# Autodesk Inventor assembly: MM0948AN140_G00_840
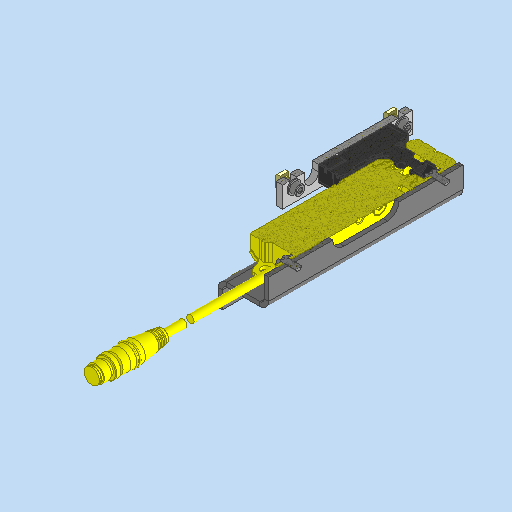
[picture p0: Inventor's stored thumbnail of the model, 512x512]
Saved by Autodesk Inventor 2023.3 (Build 273359000, 359)
## iProperties
Created: 2023-03-23
Part Number: MM0948AN140_G00_840
Project: 0850
Description: =<RBPARTNOTITLE2>
Document SubType Name: Assembly
Designer: FH/Wi
Mass: 432.694 g
Surface Area: 602.46 cm^2
Volume: 140.943 cm^3
Density: 3.07 g/cm^3
AnP_Material: =<Material>
RBMATERIAL: =<Material>
RBMATNO: =<Part Number>
RBPARTMADEOF: --
RBDRAWINGMISSINGSPEC: --
AnP_Kategorie: 98
RBPARTNOTITLE2: hier Bezeichnung eintragen
RBGBREMARKSINDEX: Angabe offen!
RBSURFACE: --
RBPARTNOTITLE1: enter description here
RBPARTNO: SIEHE MNR
Author: FH/Wi
Keywords: =<RBPARTMADEOF>
Comments: =<RBSURFACE2>
Revision Number: 01
## Documents named in this file (10)
- C:\Users\rea9an\Documents\Inventor\TCAI2412_te1910_EM\AS00000955.iam
- C:\Users\rea9an\Documents\Inventor\TCAI2412_te1910_EM\PT00004396.ipt
- C:\Users\rea9an\Documents\Inventor\TCAI2412_te1910_EM\PT00004399.ipt
- C:\Users\rea9an\Documents\Inventor\TCAI2412_te1910_EM\PT00004877.ipt
- C:\Users\rea9an\Documents\Inventor\TCAI2412_te1910_EM\PT00004664.ipt
- C:\Users\rea9an\Documents\Inventor\TCAI2412_te1910_EM\PT00004294.ipt
- C:\Users\rea9an\Documents\Inventor\TCAI2412_te1910_EM\PT00004778.ipt
- C:\Users\rea9an\Documents\Inventor\TCAI2412_te1910_EM\PT00004866.ipt
- C:\Users\rea9an\Documents\Inventor\TCAI2412_te1910_EM\PT00004666.ipt
- C:\Users\rea9an\Documents\Inventor\TCAI2412_te1910_EM\PT00004389.ipt
## Components (20 placed, 9 different names)
1. PT00004664:1 — Winkel:5, Fluchtend:7, Winkel:6, Einfügen:13, Einfügen:14
2. PT00004666:1 — Passend:8, Passend:13, Passend:14, Passend:25, Winkel:4, Fluchtend:3, Einfügen:7, Einfügen:8, Winkel:5, Fluchtend:7, Passend:30, Passend:31
3. PT00004389:1 — Einfügen:5
4. PT00004389:2 — Einfügen:6
5. PT00004877:1 — Einfügen:7
6. PT00004877:2 — Einfügen:8
7. PT00004866:1
8. PT00004866:2
9. PT00004866:3 — Fluchtend:3
10. PT00004866:4 — Passend:25
11. PT00004778:1
12. PT00004778:2
13. PT00004778:3 — Passend:13
14. PT00004778:4 — Passend:14
15. PT00004396:1 — Passend:6, Einfügen:5, Einfügen:6, Einfügen:13, Einfügen:14
16. PT00004399:1 — Passend:6, Passend:8, Passend:30, Passend:31
17. PT00004294:1 — Winkel:4, Fluchtend:5, Fluchtend:6
18. PT00004294:2 — Fluchtend:6
19. PT00004294:3 — Winkel:6
20. PT00004294:4 — Fluchtend:5
## Relationships (35: Insert 14, Mate 12, Flush 6, Angle 3)
- Passend:6 [Mate]: PT00004396:1 ↔ PT00004399:1
- Passend:8 [Mate]: PT00004666:1 ↔ PT00004399:1
- [Insert]: PT00004866:1 ↔ PT00004778:1
- [Insert]: PT00004866:2 ↔ PT00004778:2
- [Insert]: PT00004866:4 ↔ PT00004778:3
- [Insert]: PT00004866:3 ↔ PT00004778:4
- Passend:13 [Mate]: PT00004666:1 ↔ PT00004778:3
- Passend:14 [Mate]: PT00004666:1 ↔ PT00004778:4
- [Mate]: PT00004866:1 ↔ PT00004866:2
- Passend:25 [Mate] (-7.5 mm): PT00004666:1 ↔ PT00004866:4
- Winkel:4 [Angle] (0 deg): PT00004666:1 ↔ PT00004294:1
- Fluchtend:3 [Flush] (7.5 mm): PT00004666:1 ↔ PT00004866:3
- [Flush]: PT00004866:3 ↔ PT00004866:4
- Einfügen:5 [Insert]: PT00004389:1 ↔ PT00004396:1
- Einfügen:6 [Insert]: PT00004389:2 ↔ PT00004396:1
- Einfügen:7 [Insert] (8.4 mm): PT00004666:1 ↔ PT00004877:1
- Einfügen:8 [Insert] (8.4 mm): PT00004666:1 ↔ PT00004877:2
- Fluchtend:5 [Flush] (25 mm): PT00004294:1 ↔ PT00004294:4
- [Insert] (3.7 mm): PT00004778:1 ↔ PT00004294:4
- [Insert] (5.2 mm): PT00004778:3 ↔ PT00004294:1
- [Insert] (5.2 mm): PT00004778:4 ↔ PT00004294:2
- [Insert] (3.7 mm): PT00004778:2 ↔ PT00004294:3
- Fluchtend:6 [Flush]: PT00004294:1 ↔ PT00004294:2
- [Mate]: PT00004664:1 ↔ PT00004778:2
- [Mate]: PT00004664:1 ↔ PT00004778:1
- Winkel:5 [Angle] (180 deg): PT00004664:1 ↔ PT00004666:1
- Fluchtend:7 [Flush] (20 mm): PT00004664:1 ↔ PT00004666:1
- [Mate] (-16 mm): PT00004664:1 ↔ PT00004866:2
- Winkel:6 [Angle] (0 deg): PT00004664:1 ↔ PT00004294:3
- [Mate] (-16 mm): PT00004664:1 ↔ PT00004866:1
- [Flush] (6 mm): PT00004664:1 ↔ PT00004866:2
- Passend:30 [Mate]: PT00004666:1 ↔ PT00004399:1
- Passend:31 [Mate]: PT00004666:1 ↔ PT00004399:1
- Einfügen:13 [Insert]: PT00004664:1 ↔ PT00004396:1
- Einfügen:14 [Insert]: PT00004664:1 ↔ PT00004396:1
